# Autodesk Inventor assembly: AssemblyPendulum1
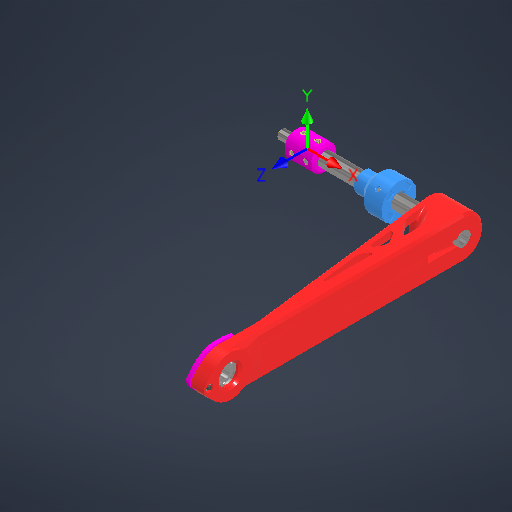
[picture p0: Inventor's stored thumbnail of the model, 512x512]
Saved by Autodesk Inventor 2027.1 (Build 311270010, 270A)
## iProperties
Created: 2026-10-15
Part Number: AssemblyPendulum1
Document SubType Name: Assembly
Designer: lucao
Mass: 169.592 g
Surface Area: 590.403 cm^2
Volume: 141.356 cm^3
Density: 1.19975 g/cm^3
Author: lucao
## Documents named in this file (21)
- C:\Users\lucao\Desktop\RL-Rotary-Inverted-Double-Pendulum\CAD\AssemblyPendulum1.iam
- C:\Users\lucao\Desktop\RL-Rotary-Inverted-Double-Pendulum\CAD\drive_shaft_arm.ipt
- C:\Users\lucao\Desktop\RL-Rotary-Inverted-Double-Pendulum\CAD\slipringMountArm.ipt
- C:\Users\lucao\Desktop\RL-Rotary-Inverted-Double-Pendulum\CAD\slipring_tube.ipt
- C:\Users\lucao\Desktop\RL-Rotary-Inverted-Double-Pendulum\CAD\slipRing.ipt
- C:\Users\lucao\Desktop\RL-Rotary-Inverted-Double-Pendulum\CAD\Insert M3 D5 L5mm\Insert M3 D5 L5mm.ipt
- C:\Users\lucao\Documents\Inventor\Content Center Files\R2027\en-US\CNS 4481\CNS 4481 - M3 x 5.ipt
- C:\Users\lucao\Documents\Inventor\Content Center Files\R2027\en-US\CNS 4481\CNS 4481 - M3 x 6.ipt
- C:\Users\lucao\Desktop\RL-Rotary-Inverted-Double-Pendulum\CAD\axialLock_arm.ipt
- C:\Users\lucao\Documents\Inventor\Content Center Files\R2027\en-US\DIN EN ISO 4036\DIN EN ISO 4036 - M3.ipt
- C:\Users\lucao\Documents\Inventor\Content Center Files\R2027\en-US\DIN 914\DIN 914 - M3 x 8.ipt
- C:\Users\lucao\Desktop\RL-Rotary-Inverted-Double-Pendulum\CAD\pendulum_1.ipt
- C:\Users\lucao\Documents\Inventor\Content Center Files\R2027\en-US\DIN BEARING(1)\DIN 625 SKF - SKF 608.ipt
- C:\Users\lucao\Desktop\RL-Rotary-Inverted-Double-Pendulum\CAD\sensormout_pendulum.ipt
- C:\Users\lucao\Documents\Inventor\Content Center Files\R2027\en-US\ISO 10642(2)\ISO 10642  - M3  x  16.ipt
- C:\Users\lucao\Documents\Inventor\Content Center Files\R2027\en-US\DIN EN 24 036(2)\DIN EN 24 036 - M3.ipt
- C:\Users\lucao\Desktop\RL-Rotary-Inverted-Double-Pendulum\CAD\Insert M3 D5 L5mm\Insert M3 D5 L5mm_MIR1.ipt
- C:\Users\lucao\Documents\Inventor\Content Center Files\R2027\en-US\ISO 10642(2)\ISO 10642  - M3  x  10.ipt
- C:\Users\lucao\Documents\Inventor\Content Center Files\R2027\en-US\ISO 4032(1)\ISO 4032 - M4DIN EN.ipt
- C:\Users\lucao\Documents\Inventor\Content Center Files\R2027\en-US\DIN 914\DIN 914 - M4 x 12.ipt
- C:\Users\lucao\Desktop\RL-Rotary-Inverted-Double-Pendulum\CAD\as5048a.ipt
## Components (41 placed, 20 different names)
1. drive_shaft_arm:1 — Mate:40, Mate:41
2. slipringMountArm:1 — Mate:40, Flush:11
3. slipring_tube:1 — Flush:11, Flush:12
4. slipRing:1 — Mate:42
5. axialLock_arm:1 — Flush:12
6. pendulum_1:1 — Flush:14
7. DIN 625 SKF SKF 608:1
8. sensormout_pendulum:1 — Mate:37, Mate:38, Mate:39
9. DIN EN ISO 10642 M3  x  16:1
10. DIN EN 24036 M3:1
11. Insert M3 D5 L5mm:10
12. Insert M3 D5 L5mm_MIR1:1
13. DIN EN ISO 10642 M3  x  10:1
14. DIN EN ISO 10642 M3  x  10:2
15. DIN EN 24032 M4:1
16. DIN 914 M4 x 12:1
17. as5048a:1 — Mate:37, Mate:38, Mate:39
18. Insert M3 D5 L5mm:1
19. Insert M3 D5 L5mm:2
20. Insert M3 D5 L5mm:3
21. Insert M3 D5 L5mm:4
22. Insert M3 D5 L5mm:5
23. Insert M3 D5 L5mm:6
24. Insert M3 D5 L5mm:7
25. Insert M3 D5 L5mm:8
26. CNS 4481 M3 x 5:1
27. CNS 4481 M3 x 5:2
28. CNS 4481 M3 x 5:3
29. CNS 4481 M3 x 5:4
30. CNS 4481 M3 x 6:1
31. CNS 4481 M3 x 6:2
32. CNS 4481 M3 x 6:3
33. CNS 4481 M3 x 6:4
34. DIN EN ISO 4036 M3:1
35. DIN EN ISO 4036 M3:2
36. DIN EN ISO 4036 M3:3
37. DIN EN ISO 4036 M3:4
38. DIN 914 M3 x 8:1
39. DIN 914 M3 x 8:2
40. DIN 914 M3 x 8:3
41. DIN 914 M3 x 8:4
## Component patterns: (4 elements, first: Insert M3 D5 L5mm:1), (4 elements, first: Insert M3 D5 L5mm:5), (4 elements, first: CNS 4481 M3 x 5:1), (4 elements, first: CNS 4481 M3 x 6:1), (4 elements, first: DIN EN ISO 4036 M3:1), (4 elements, first: DIN 914 M3 x 8:1)
## Relationships (49: Mate 35, Flush 11, Angle 3)
- [Mate]: drive_shaft_arm:1 ↔ slipringMountArm:1
- [Mate]: drive_shaft_arm:1 ↔ slipring_tube:1
- [Mate]: slipring_tube:1 ↔ slipRing:1
- [Flush]: slipring_tube:1 ↔ slipRing:1
- [Mate]: slipringMountArm:1 ↔ Insert M3 D5 L5mm:1
- [Flush]: slipringMountArm:1 ↔ Insert M3 D5 L5mm:1
- [Mate]: slipringMountArm:1 ↔ Insert M3 D5 L5mm:5
- [Flush]: slipringMountArm:1 ↔ Insert M3 D5 L5mm:5
- [Mate]: slipringMountArm:1 ↔ CNS 4481 M3 x 5:1
- [Mate]: slipringMountArm:1 ↔ CNS 4481 M3 x 5:1
- [Mate]: slipringMountArm:1 ↔ CNS 4481 M3 x 6:1
- [Flush] (0.3 mm): slipringMountArm:1 ↔ CNS 4481 M3 x 6:1
- [Mate]: drive_shaft_arm:1 ↔ axialLock_arm:1
- [Mate]: axialLock_arm:1 ↔ DIN EN ISO 4036 M3:1
- [Angle] (0 deg): axialLock_arm:1 ↔ DIN EN ISO 4036 M3:1
- [Mate]: axialLock_arm:1 ↔ DIN EN ISO 4036 M3:1
- [Mate]: axialLock_arm:1 ↔ DIN 914 M3 x 8:1
- [Mate] (-2 mm): axialLock_arm:1 ↔ DIN 914 M3 x 8:1
- [Mate]: drive_shaft_arm:1 ↔ pendulum_1:1
- [Flush]: drive_shaft_arm:1 ↔ pendulum_1:1
- [Mate]: pendulum_1:1 ↔ DIN 625 SKF SKF 608:1
- [Mate]: pendulum_1:1 ↔ sensormout_pendulum:1
- [Mate]: pendulum_1:1 ↔ sensormout_pendulum:1
- [Mate]: DIN 625 SKF SKF 608:1 ↔ sensormout_pendulum:1
- [Mate]: pendulum_1:1 ↔ DIN 625 SKF SKF 608:1
- [Mate]: sensormout_pendulum:1 ↔ DIN EN ISO 10642 M3  x  16:1
- [Mate]: DIN EN ISO 10642 M3  x  16:1 ↔ DIN EN 24036 M3:1
- [Mate]: pendulum_1:1 ↔ DIN EN 24036 M3:1
- [Angle] (0 deg): pendulum_1:1 ↔ DIN EN 24036 M3:1
- [Mate]: pendulum_1:1 ↔ Insert M3 D5 L5mm:10
- [Flush]: pendulum_1:1 ↔ Insert M3 D5 L5mm:10
- [Mate]: sensormout_pendulum:1 ↔ DIN EN ISO 10642 M3  x  10:1
- [Mate]: sensormout_pendulum:1 ↔ DIN EN ISO 10642 M3  x  10:2
- [Mate]: pendulum_1:1 ↔ DIN EN 24032 M4:1
- [Mate]: pendulum_1:1 ↔ DIN EN 24032 M4:1
- [Angle] (0 deg): pendulum_1:1 ↔ DIN EN 24032 M4:1
- [Mate]: DIN EN 24032 M4:1 ↔ DIN 914 M4 x 12:1
- [Flush] (1 mm): pendulum_1:1 ↔ DIN 914 M4 x 12:1
- [Mate]: pendulum_1:1 ↔ Insert M3 D5 L5mm_MIR1:1
- [Flush]: pendulum_1:1 ↔ Insert M3 D5 L5mm_MIR1:1
- Mate:37: sensormout_pendulum:1 ↔ as5048a:1
- Mate:38: sensormout_pendulum:1 ↔ as5048a:1
- Mate:39: sensormout_pendulum:1 ↔ as5048a:1
- Mate:40: drive_shaft_arm:1 ↔ slipringMountArm:1
- Flush:11 (11.5 mm): slipringMountArm:1 ↔ slipring_tube:1
- Flush:12 (-69.5 mm): slipring_tube:1 ↔ axialLock_arm:1
- Mate:41: drive_shaft_arm:1
- Mate:42 (-23.5 mm): slipRing:1
- Flush:14: pendulum_1:1
